# Autodesk Inventor assembly: OT2-Pipette V0.3 - eject variant
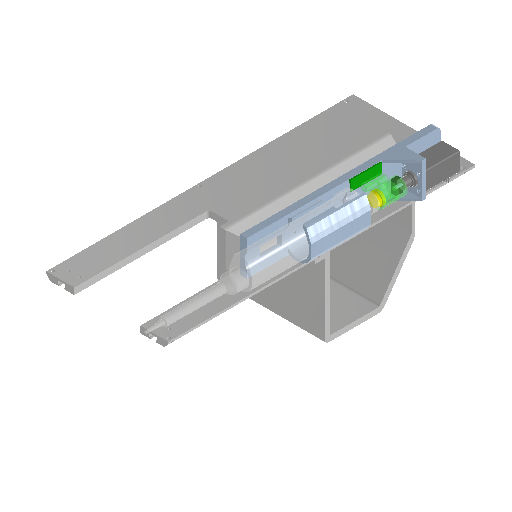
[picture p0: Inventor's stored thumbnail of the model, 512x512]
Saved by Autodesk Inventor 2025.5 (Build 295498000, 498)
## iProperties
Created: 2026-11-01
Part Number: OT2-Pipette V0.3 - eject variant
Description: ONiLAB 0.1-2.5 ul pipette as OT-2 tool (P20 GEN2 emulation), adapter frame; parameters linked from OT2-Pipette V0.3 - parameters.ipt
Document SubType Name: Assembly
Designer: benir
Author: benir
## Documents named in this file (13)
- C:\Users\benir\Documents\openUC2-OT2-PlateGripper\PipetteTool\INVENTOR\OT2-Pipette V0.3 - eject variant.iam
- C:\Users\benir\Documents\openUC2-OT2-PlateGripper\PipetteTool\INVENTOR\OT2-Pipette V0.3 - parameters.ipt
- C:\Users\benir\Documents\openUC2-OT2-PlateGripper\PipetteTool\INVENTOR\OT2-Pipette V0.3 - frame.ipt
- C:\Users\benir\Documents\openUC2-OT2-PlateGripper\PipetteTool\INVENTOR\OT2-Pipette V0.3 - yoke eject variant.ipt
- C:\Users\benir\Documents\openUC2-OT2-PlateGripper\PipetteTool\INVENTOR\OT2-Pipette V0.3 - spring pad.ipt
- C:\Users\benir\Documents\openUC2-CAD-new\Workspace\BUY\BUY - Stepping motor - 20K-2AB-12.7 - YPF Motors.ipt
- C:\Users\benir\Documents\openUC2-OT2-PlateGripper\PipetteTool\INVENTOR\BUY - Omron - micro switch - D2F-L - OT2-Pipette V0.3 placeholder.ipt
- C:\Users\benir\Documents\openUC2-OT2-PlateGripper\PipetteTool\INVENTOR\REF - OT2-Pipette V0.3 - identity board + 2x5 header.ipt
- C:\Users\benir\Documents\openUC2-OT2-PlateGripper\INVENTOR\Threaded Insert-Ruthex-M3.ipt
- C:\Users\benir\Documents\openUC2-OT2-PlateGripper\PipetteTool\INVENTOR\REF - OT2-Pipette V0.3 - ONiLAB envelope.ipt
- C:\Users\benir\Documents\openUC2-OT2-PlateGripper\INVENTOR\00_OT-2 Reference_Pipettte.ipt
- C:\Users\benir\Documents\openUC2-OT2-PlateGripper\INVENTOR\OT2-Gripper V1-1 - OT2-interface adapter.ipt
- C:\Users\benir\Documents\openUC2-OT2-PlateGripper\PipetteGrabCad\ONiLAB-Dev-Core.ipt
## Components (13 placed, 11 different names)
1. OT2-Pipette V0.3 - frame:1 — yoke eject: YZ Plane, yoke eject: XZ Plane, yoke eject: XY Plane, spring pad: YZ Plane, spring pad: XZ Plane, spring pad: XY Plane, actuator: YZ Plane, actuator: XZ Plane, actuator: XY Plane, home switch: YZ Plane, home switch: XZ Plane, home switch: XY Plane, identity board: YZ Plane, identity board: XZ Plane, identity board: XY Plane, insert 1: Y Axis, insert 1: XZ Plane, insert 2: Y Axis, insert 2: XZ Plane, insert 3: Y Axis, insert 3: XZ Plane, pipette envelope: YZ Plane, pipette envelope: XZ Plane, pipette envelope: XY Plane, OT-2 mount bar (reference model): YZ Plane, OT-2 mount bar (reference model): XZ Plane, OT-2 mount bar (reference model): XY Plane, gripper adapter (same frame): YZ Plane, gripper adapter (same frame): XZ Plane, gripper adapter (same frame): XY Plane, ONiLAB-Dev-Core (with hook): YZ Plane, ONiLAB-Dev-Core (with hook): XZ Plane, ONiLAB-Dev-Core (with hook): XY Plane
2. OT2-Pipette V0.3 - yoke eject variant:1 — yoke eject: YZ Plane, yoke eject: XZ Plane, yoke eject: XY Plane
3. OT2-Pipette V0.3 - spring pad:1 — spring pad: YZ Plane, spring pad: XZ Plane, spring pad: XY Plane
4. BUY - Stepping motor - 20K-2AB-12.7 - YPF Motors:1 — actuator: YZ Plane, actuator: XZ Plane, actuator: XY Plane
5. BUY - Omron - micro switch - D2F-L - OT2-Pipette V0.3 placeholder:1 — home switch: YZ Plane, home switch: XZ Plane, home switch: XY Plane
6. REF - OT2-Pipette V0.3 - identity board + 2x5 header:1 — identity board: YZ Plane, identity board: XZ Plane, identity board: XY Plane
7. Threaded Insert-Ruthex-M3:1 — insert 1: Y Axis, insert 1: XZ Plane
8. Threaded Insert-Ruthex-M3:2 — insert 2: Y Axis, insert 2: XZ Plane
9. Threaded Insert-Ruthex-M3:3 — insert 3: Y Axis, insert 3: XZ Plane
10. REF - OT2-Pipette V0.3 - ONiLAB envelope:1 — pipette envelope: YZ Plane, pipette envelope: XZ Plane, pipette envelope: XY Plane
11. 00_OT-2 Reference_Pipettte:1 — OT-2 mount bar (reference model): YZ Plane, OT-2 mount bar (reference model): XZ Plane, OT-2 mount bar (reference model): XY Plane
12. OT2-Gripper V1-1 - OT2-interface adapter:1 — gripper adapter (same frame): YZ Plane, gripper adapter (same frame): XZ Plane, gripper adapter (same frame): XY Plane
13. ONiLAB-Dev-Core:1 — ONiLAB-Dev-Core (with hook): YZ Plane, ONiLAB-Dev-Core (with hook): XZ Plane, ONiLAB-Dev-Core (with hook): XY Plane
## Relationships (33: Flush 26, Mate 7)
- yoke eject: YZ Plane [Flush]: OT2-Pipette V0.3 - frame:1 ↔ OT2-Pipette V0.3 - yoke eject variant:1
- yoke eject: XZ Plane [Flush]: OT2-Pipette V0.3 - frame:1 ↔ OT2-Pipette V0.3 - yoke eject variant:1
- yoke eject: XY Plane [Flush]: OT2-Pipette V0.3 - frame:1 ↔ OT2-Pipette V0.3 - yoke eject variant:1
- spring pad: YZ Plane [Flush]: OT2-Pipette V0.3 - frame:1 ↔ OT2-Pipette V0.3 - spring pad:1
- spring pad: XZ Plane [Flush]: OT2-Pipette V0.3 - frame:1 ↔ OT2-Pipette V0.3 - spring pad:1
- spring pad: XY Plane [Flush]: OT2-Pipette V0.3 - frame:1 ↔ OT2-Pipette V0.3 - spring pad:1
- actuator: YZ Plane [Flush]: OT2-Pipette V0.3 - frame:1 ↔ BUY - Stepping motor - 20K-2AB-12.7 - YPF Motors:1
- actuator: XZ Plane [Flush]: OT2-Pipette V0.3 - frame:1 ↔ BUY - Stepping motor - 20K-2AB-12.7 - YPF Motors:1
- actuator: XY Plane [Flush]: OT2-Pipette V0.3 - frame:1 ↔ BUY - Stepping motor - 20K-2AB-12.7 - YPF Motors:1
- home switch: YZ Plane [Flush]: OT2-Pipette V0.3 - frame:1 ↔ BUY - Omron - micro switch - D2F-L - OT2-Pipette V0.3 placeholder:1
- home switch: XZ Plane [Flush]: OT2-Pipette V0.3 - frame:1 ↔ BUY - Omron - micro switch - D2F-L - OT2-Pipette V0.3 placeholder:1
- home switch: XY Plane [Flush]: OT2-Pipette V0.3 - frame:1 ↔ BUY - Omron - micro switch - D2F-L - OT2-Pipette V0.3 placeholder:1
- identity board: YZ Plane [Flush]: OT2-Pipette V0.3 - frame:1 ↔ REF - OT2-Pipette V0.3 - identity board + 2x5 header:1
- identity board: XZ Plane [Flush]: OT2-Pipette V0.3 - frame:1 ↔ REF - OT2-Pipette V0.3 - identity board + 2x5 header:1
- identity board: XY Plane [Flush]: OT2-Pipette V0.3 - frame:1 ↔ REF - OT2-Pipette V0.3 - identity board + 2x5 header:1
- insert 1: Y Axis [Mate]: OT2-Pipette V0.3 - frame:1 ↔ Threaded Insert-Ruthex-M3:1
- insert 1: XZ Plane [Mate] (5.7 mm): OT2-Pipette V0.3 - frame:1 ↔ Threaded Insert-Ruthex-M3:1
- insert 2: Y Axis [Mate]: OT2-Pipette V0.3 - frame:1 ↔ Threaded Insert-Ruthex-M3:2
- insert 2: XZ Plane [Mate] (5.7 mm): OT2-Pipette V0.3 - frame:1 ↔ Threaded Insert-Ruthex-M3:2
- insert 3: Y Axis [Mate]: OT2-Pipette V0.3 - frame:1 ↔ Threaded Insert-Ruthex-M3:3
- insert 3: XZ Plane [Mate] (5.7 mm): OT2-Pipette V0.3 - frame:1 ↔ Threaded Insert-Ruthex-M3:3
- pipette envelope: YZ Plane [Flush]: OT2-Pipette V0.3 - frame:1 ↔ REF - OT2-Pipette V0.3 - ONiLAB envelope:1
- pipette envelope: XZ Plane [Flush]: OT2-Pipette V0.3 - frame:1 ↔ REF - OT2-Pipette V0.3 - ONiLAB envelope:1
- pipette envelope: XY Plane [Flush]: OT2-Pipette V0.3 - frame:1 ↔ REF - OT2-Pipette V0.3 - ONiLAB envelope:1
- OT-2 mount bar (reference model): YZ Plane [Flush] (60.5 mm): OT2-Pipette V0.3 - frame:1 ↔ 00_OT-2 Reference_Pipettte:1
- OT-2 mount bar (reference model): XZ Plane [Flush] (441.5 mm): OT2-Pipette V0.3 - frame:1 ↔ 00_OT-2 Reference_Pipettte:1
- OT-2 mount bar (reference model): XY Plane [Flush] (83.445 mm): OT2-Pipette V0.3 - frame:1 ↔ 00_OT-2 Reference_Pipettte:1
- gripper adapter (same frame): YZ Plane [Flush]: OT2-Pipette V0.3 - frame:1 ↔ OT2-Gripper V1-1 - OT2-interface adapter:1
- gripper adapter (same frame): XZ Plane [Flush]: OT2-Pipette V0.3 - frame:1 ↔ OT2-Gripper V1-1 - OT2-interface adapter:1
- gripper adapter (same frame): XY Plane [Flush]: OT2-Pipette V0.3 - frame:1 ↔ OT2-Gripper V1-1 - OT2-interface adapter:1
- ONiLAB-Dev-Core (with hook): YZ Plane [Flush] (-19.88 mm): OT2-Pipette V0.3 - frame:1 ↔ ONiLAB-Dev-Core:1
- ONiLAB-Dev-Core (with hook): XZ Plane [Flush] (66 mm): OT2-Pipette V0.3 - frame:1 ↔ ONiLAB-Dev-Core:1
- ONiLAB-Dev-Core (with hook): XY Plane [Mate] (8.2 mm): OT2-Pipette V0.3 - frame:1 ↔ ONiLAB-Dev-Core:1
## Named parameters: mount_x = -9.5 mm, env_x1 = 22.84 mm, env_z = 18.75 mm, adapter_top = 53 mm, datum_y = 168 mm, bar_top = 123.65 mm, p20_top_to_nozzle = 330.5 mm, shroud_drop = 273.3 mm, nozzle_offset = -5 mm, plate_y0 = -49 mm, wall_x1 = -2.2 mm, insert_d = 4.1 mm, insert_x_end = -2.8 mm, insert_len = 5.7 mm, insert_cb_d = 6 mm, insert_cb_h = 0.3 mm, ins_top_y = 46 mm, ins_bot_y = -43 mm, ins_z = 13.25 mm, wall_fillet = 4 mm, cut_over = 1 mm, pip_x = 8.2 mm, pip_z = -3.46 mm, body_r = 12.33 mm, body_hw = 12 mm, body_len = 121 mm, body_flat_d = 5.17 mm, body_ch_w = 9.78 mm, body_ch_d = 10.75 mm, nose_hw = 7 mm, nose_r = 13.25 mm, nose_c = 6 mm, knob_d = 16.6 mm, knob_h = 7 mm, knob_above_body = 18.5 mm, plunger_d = 9.9 mm, collar_d = 18.1 mm, collar_len = 12.6 mm, taper_len = 7.2 mm, sleeve_d0 = 9.4 mm, sleeve_d1 = 8.6 mm, sleeve_len = 62.6 mm, cone_d0 = 4.7 mm, cone_d1 = 2.4 mm, cone_len = 19.1 mm, ej_d0 = 12.3 mm, ej_d1 = 21.5 mm, ej_hw = 5 mm, ej_top_below = 2.5 mm, ej_h = 14.5 mm, disp_y0 = 33 mm, disp_y1 = 56 mm, pad_gap = 0.5 mm, stroke1 = 5 mm, stroke2 = 3 mm, eject_gap = 0.5 mm, eject_stroke = 7 mm, eject_over = 0.5 mm, mot_sq = 20 mm, mot_len = 37.35 mm, mot_pilot_d = 16 mm, mot_pilot_h = 1.5 mm, mot_boss_d = 13 mm, mot_boss_h = 5.6 mm, mot_nut_d = 9 mm, mot_nut_h = 14.8 mm, mot_holes = 15.4 mm, shaft_d = 3.5 mm, thread_d = 2.5 mm, thread_len = 5 mm, mot_stroke = 12.7 mm, shaft_out = 15.8 mm, conn_y0 = 29.65 mm, conn_y1 = 34.65 mm, conn_out = 2.8 mm, home_margin = 1.2 mm, end_margin = 0.3 mm, shelf_t = 4 mm, shelf_back = 0.5 mm, shelf_side = 1 mm, env_margin = 0.3 mm, gusset_t = 2.5 mm, pilot_clr = 0.4 mm, boss_clr = 0.8 mm, m2_clear_d = 2.4 mm, driver_d = 4.4 mm, yoke_d = 18 mm, yoke_total = 28 mm, disc_h = 7 mm, insert_m25 = 3.6 mm, insert_m25_depth = 6 mm, pad_d = 13 mm, tab_x0 = 0 mm, tab_h = 3 mm, tab_z_in = 1 mm, skirt_id = 14.6 mm, slot_y0 = 1.3 mm, slot_hw = 1.2 mm, slot_half_len = 10 mm, pin_y = 2.5 mm, slot_end = 2.2 mm, flange_d = 14 mm, flange_h = 3 mm, flange_gap = 1 mm, pin_d = 1.6 mm, nose_d = 12 mm, nose_out = 3 mm, arm_w = 6 mm, arm_t = 5 mm, arm_y = 4 mm, arm_r = 16.5 mm, boss_d = 7 mm, boss_h = 6 mm, screw_out = 3 mm, m3_tap_d = 2.5 mm, sw_l = 12.8 mm, sw_w = 5.8 mm, sw_h = 6.5 mm, sw_z0 = -16 mm, sw_trigger = 0.6 mm, sw_pitch = 6.5 mm, sw_hole_down = 2.9 mm, sw_pilot_d = 1.8 mm, lever_drop = 1.5 mm, lever_clear = 0.2 mm, lever_x0 = 1.5 mm, lever_x1 = 4.3 mm, lever_inset = 1 mm, hole_depth = 6 mm, clr = 0.3 mm, wall = 3 mm, sleeve_bottom = 60 mm, ledge_t = 2.5 mm, knob_hole_d = 18.2 mm, body_cut_below = 30 mm, ej_slot_clr = 0.6 mm, ej_slot_z = 0.5 mm, eject_win_d = 8.5 mm, eject_win_h = 28 mm, eject_win_hw = 8 mm, disp_hw = 6 mm, grub_y1 = 70 mm, grub_y2 = 108 mm, grub_d = 2.5 mm, grub_into = 1 mm, hdr_y = 76 mm, hdr_z = 13 mm, hdr_l = 20.9 mm, hdr_w = 9.5 mm, hdr_body_l = 20.3 mm, hdr_body_w = 8.9 mm, hdr_in = 0.5 mm, pcb_t = 1.6 mm, pcb_margin = 6 mm, pcb_hw = 5.5 mm, pcb_hole_d = 2.2 mm, pcb_hole_off = 3.5 mm, st_w = 127.76 mm, st_d = 85.48 mm, st_h = 60 mm, st_base_t = 3 mm, st_plate_t = 4 mm, st_side_x = 8 mm, st_side_w = 6 mm, st_front = 20 mm, st_back = 4 mm, st_back_t = 3 mm, st_x1 = 40 mm, st_pitch = 24 mm, st_entry_z = 60 mm, st_entry_d = 9.5 mm, st_slot_len = 22 mm, st_slot_w = 4.4 mm, p20_nozzle = -162.5 mm, cone_end = -167.5 mm, lower_len = 101.5 mm, body_bottom = -66 mm, body_top = 55 mm, knob_top = 73.5 mm, ej_top = 52.5 mm, top_y = 102 mm, retracted = 103.2 mm, mot_front = 119 mm, mot_rear = 156.35 mm, headroom = 11.65 mm, shroud_y = -105.3 mm, sleeve_y0 = -6 mm, u_max = 11.2 mm, u_bottom = 5.5 mm, u_blowout = 8.5 mm, u_eject0 = 9 mm, u_drop = 16.5 mm, stroke_for_eject = 18 mm, shelf_x1 = 19.2 mm, gusset_h = 21.4 mm, sw_y0 = 103.7 mm, pad_face = 74 mm, skirt_y0 = 77 mm, arm_y0 = 81 mm, slot_y1 = 89.2 mm, eject_tip_y = 61.5 mm, arm_boss_y = 64.5 mm, wall_out = 3.3 mm, knob_y0 = 66.5 mm, pcb_y0 = 59.55 mm, pcb_z1 = 18.5 mm, st_x2 = 64 mm, st_x3 = 88 mm, travel = 0 mm, bar_dx = -60.5 mm, bar_dy = -441.5 mm, bar_dz = -83.445 mm, devcore_dz = 23.34 mm
